# Autodesk Inventor assembly: Assembly Robotic Arm
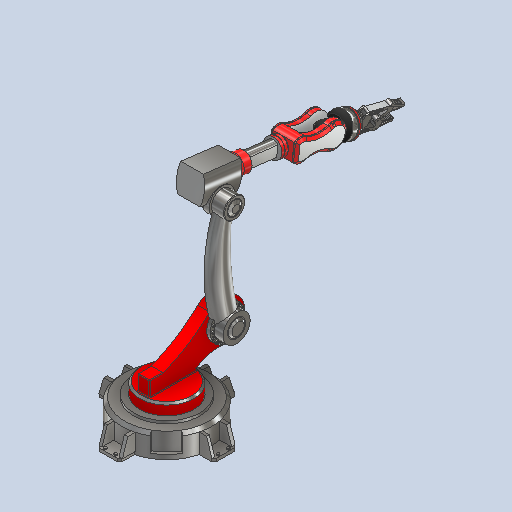
[picture p0: Inventor's stored thumbnail of the model, 512x512]
Saved by Autodesk Inventor 2027.1 (Build 311270010, 270A)
## iProperties
Part Number: Assembly Robotic Arm
Document SubType Name: Baugruppe
Designer: Asus
Author: Asus
## Documents named in this file (10)
- C:\Users\Asus\OneDrive\Desktop\Robotic Arm\Assembly Robotic Arm.iam
- C:\Users\Asus\OneDrive\Desktop\Robotic Arm\1.ipt
- C:\Users\Asus\OneDrive\Desktop\Robotic Arm\2.ipt
- C:\Users\Asus\OneDrive\Desktop\Robotic Arm\3.ipt
- C:\Users\Asus\OneDrive\Desktop\Robotic Arm\4.ipt
- C:\Users\Asus\OneDrive\Desktop\Robotic Arm\5.ipt
- C:\Users\Asus\OneDrive\Desktop\Robotic Arm\6.ipt
- C:\Users\Asus\OneDrive\Desktop\Robotic Arm\7.ipt
- C:\Users\Asus\OneDrive\Desktop\Robotic Arm\8.ipt
- C:\Users\Asus\OneDrive\Desktop\Robotic Arm\9.ipt
## Components (11 placed, 9 different names)
1. 1:1 — Passend:1, Passend:2
2. 2:1 — Passend:1, Passend:2, Passend:3, Passend:4
3. 3:1 — Passend:3, Passend:4, Passend:5, Passend:6
4. 4:1 — Passend:5, Passend:6, Passend:7, Passend:8
5. 5:1 — Passend:7, Passend:8, Passend:9, Passend:10, Winkel:1, Winkel:2
6. 6:1 — Passend:9, Passend:10, Passend:11, Passend:12
7. 7:1 — Passend:11, Passend:12, Passend:13, Passend:14, Passend:15, Passend:16, Passend:17, Passend:18, Passend:19, Passend:20
8. 8:1 — Passend:13, Passend:14
9. 8:2 — Passend:15, Passend:16
10. 9:1 — Passend:19, Passend:20
11. 9:2 — Passend:17, Passend:18
## Relationships (22: Mate 20, Angle 2)
- Passend:1 [Mate]: 1:1 ↔ 2:1
- Passend:2 [Mate]: 1:1 ↔ 2:1
- Passend:3 [Mate]: 2:1 ↔ 3:1
- Passend:4 [Mate]: 2:1 ↔ 3:1
- Passend:5 [Mate]: 3:1 ↔ 4:1
- Passend:6 [Mate]: 3:1 ↔ 4:1
- Passend:7 [Mate]: 4:1 ↔ 5:1
- Passend:8 [Mate]: 4:1 ↔ 5:1
- Passend:9 [Mate]: 5:1 ↔ 6:1
- Passend:10 [Mate]: 5:1 ↔ 6:1
- Passend:11 [Mate]: 6:1 ↔ 7:1
- Passend:12 [Mate]: 6:1 ↔ 7:1
- Winkel:1 [Angle] (0 deg): 5:1
- Winkel:2 [Angle] (0 deg): 5:1
- Passend:13 [Mate]: 7:1 ↔ 8:1
- Passend:14 [Mate]: 7:1 ↔ 8:1
- Passend:15 [Mate]: 7:1 ↔ 8:2
- Passend:16 [Mate]: 7:1 ↔ 8:2
- Passend:17 [Mate]: 7:1 ↔ 9:2
- Passend:18 [Mate]: 7:1 ↔ 9:2
- Passend:19 [Mate]: 7:1 ↔ 9:1
- Passend:20 [Mate]: 7:1 ↔ 9:1
